# Autodesk Inventor assembly: 1.4_EndEffector
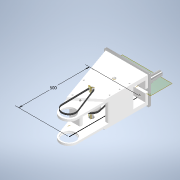
[picture p0: Inventor's stored thumbnail of the model, 180x180]
Saved by Autodesk Inventor 2021 (Build 250183000, 183)
## iProperties
Created: 2025-11-13
Part Number: 1.4_EndEffector
Document SubType Name: Assembly
Designer: Admin
Mass: 13627.3 g
Surface Area: 10535.7 cm^2
Volume: 8904.12 cm^3
Density: 1.53045 g/cm^3
Author: Admin
## Documents named in this file (32)
- C:\Users\Admin\OneDrive - Politecnico di Milano\File di Erwin Rafael Novicio - Industrial Robotics SY 25-26\3D Model\COBOT - no shaftkeys\1.1_FixedArm.iam
- C:\Users\Admin\OneDrive - Politecnico di Milano\File di Erwin Rafael Novicio - Industrial Robotics SY 25-26\3D Model\COBOT - no shaftkeys\1.1_1_SideArm.ipt
- C:\Users\Admin\OneDrive - Politecnico di Milano\File di Erwin Rafael Novicio - Industrial Robotics SY 25-26\3D Model\COBOT - no shaftkeys\HG-MR23B-K.ipt
- C:\Users\Admin\OneDrive - Politecnico di Milano\File di Erwin Rafael Novicio - Industrial Robotics SY 25-26\3D Model\COBOT - no shaftkeys\1.1_3_Shaft_A.ipt
- C:\Users\Admin\OneDrive - Politecnico di Milano\File di Erwin Rafael Novicio - Industrial Robotics SY 25-26\3D Model\COBOT - no shaftkeys\1.1_4_Shaft_B.ipt
- C:\Users\Admin\OneDrive - Politecnico di Milano\File di Erwin Rafael Novicio - Industrial Robotics SY 25-26\3D Model\COBOT - no shaftkeys\1.1_2_SideArmClose.ipt
- C:\Users\Admin\OneDrive - Politecnico di Milano\File di Erwin Rafael Novicio - Industrial Robotics SY 25-26\3D Model\COBOT - no shaftkeys\BEARING_61903-2RZ.ipt
- C:\Users\Admin\OneDrive - Politecnico di Milano\File di Erwin Rafael Novicio - Industrial Robotics SY 25-26\3D Model\COBOT - no shaftkeys\1.1_5_Base.ipt
- C:\Users\Admin\OneDrive - Politecnico di Milano\File di Erwin Rafael Novicio - Industrial Robotics SY 25-26\3D Model\COBOT - no shaftkeys\Timing_Pulley_22002-051015.ipt
- C:\Users\Admin\OneDrive - Politecnico di Milano\File di Erwin Rafael Novicio - Industrial Robotics SY 25-26\3D Model\COBOT - no shaftkeys\BEARING_628-2Z.ipt
- C:\Users\Admin\Documents\Inventor\Content Center Files\R2021\en-US\ISO 4762(2)\ISO 4762 - M5 x 25ISO.ipt
- C:\Users\Admin\Documents\Inventor\Content Center Files\R2021\en-US\ISO 7042(2)\ISO 7042 - M5 - ISO.ipt
- C:\Users\Admin\OneDrive - Politecnico di Milano\File di Erwin Rafael Novicio - Industrial Robotics SY 25-26\3D Model\COBOT - no shaftkeys\M6 Unheaded Heat-Sert Insert for Plastic.ipt
- C:\Users\Admin\OneDrive - Politecnico di Milano\File di Erwin Rafael Novicio - Industrial Robotics SY 25-26\3D Model\COBOT - no shaftkeys\Timing_Pulley_22002-051060_V3.ipt
- C:\Users\Admin\Documents\Inventor\Content Center Files\R2021\en-US\DIN 471(1)\DIN 471 - 10x1.ipt
- C:\Users\Admin\OneDrive - Politecnico di Milano\File di Erwin Rafael Novicio - Industrial Robotics SY 25-26\3D Model\COBOT - no shaftkeys\1.1_6_SpacerA.ipt
- C:\Users\Admin\OneDrive - Politecnico di Milano\File di Erwin Rafael Novicio - Industrial Robotics SY 25-26\3D Model\COBOT - no shaftkeys\Timing_Pulley_22002-051060_V1.ipt
- C:\Users\Admin\Documents\Inventor\Content Center Files\R2021\en-US\DIN 471(1)\DIN 471 - 14x1.ipt
- C:\Users\Admin\OneDrive - Politecnico di Milano\File di Erwin Rafael Novicio - Industrial Robotics SY 25-26\3D Model\COBOT - no shaftkeys\1.1_7_SpacerB.ipt
- C:\Users\Admin\Documents\Inventor\Content Center Files\R2021\en-US\ISO 7042(2)\ISO 7042 - M8 - ISO.ipt
- C:\Users\Admin\Documents\Inventor\Content Center Files\R2021\en-US\ISO 4762(2)\ISO 4762 - M8 x 30ISO.ipt
- C:\Users\Admin\OneDrive - Politecnico di Milano\File di Erwin Rafael Novicio - Industrial Robotics SY 25-26\3D Model\COBOT - no shaftkeys\Timing_Pulley_22002-051020_V1.ipt
- C:\Users\Admin\Documents\Inventor\Content Center Files\R2021\en-US\DIN 835\DIN 835 - M4 x 25 - 0.7.ipt
- C:\Users\Admin\Documents\Inventor\Content Center Files\R2021\en-US\DIN 439-2\DIN 439 - M4 x 0.7.ipt
- C:\Users\Admin\Documents\Inventor\Content Center Files\R2021\en-US\DIN 555\DIN 555-5 - M4.ipt
- C:\Users\Admin\OneDrive - Politecnico di Milano\File di Erwin Rafael Novicio - Industrial Robotics SY 25-26\3D Model\COBOT - no shaftkeys\1.2_4_SpacerA.ipt
- C:\Users\Admin\OneDrive - Politecnico di Milano\File di Erwin Rafael Novicio - Industrial Robotics SY 25-26\3D Model\COBOT - no shaftkeys\1.2_5_SpacerB.ipt
- C:\Users\Admin\Documents\Inventor\Content Center Files\R2021\en-US\ISO 4762(2)\ISO 4762 - M6 x 25ISO.ipt
- C:\Users\Admin\Documents\Inventor\Content Center Files\R2021\en-US\ISO 4762(2)\ISO 4762 - M8 x 35ISO.ipt
- C:\Users\Admin\OneDrive - Politecnico di Milano\File di Erwin Rafael Novicio - Industrial Robotics SY 25-26\3D Model\COBOT - no shaftkeys\TiminigBelt_D.ipt
- C:\Users\Admin\OneDrive - Politecnico di Milano\File di Erwin Rafael Novicio - Industrial Robotics SY 25-26\3D Model\COBOT - no shaftkeys\TiminigBelt_E.ipt
- C:\Users\Admin\OneDrive - Politecnico di Milano\File di Erwin Rafael Novicio - Industrial Robotics SY 25-26\3D Model\COBOT - no shaftkeys\TiminigBelt_F.ipt
## Components (57 placed, 31 different names)
1. 1.1_1_SideArm:1 — Mate:1, Flush:1, Mate:2, Mate:4, Mate:16, Mate:17, Mate:18, Mate:19, Mate:20, Flush:4, Mate:21, Mate:29, Mate:30, Flush:7, Mate:31, Mate:39, Mate:52, Mate:54, Mate:63, Mate:64, Flush:10, Flush:11, Mate:65, Mate:66, Mate:67, Mate:68, Mate:69, Flush:12, Flush:13, Flush:14, Flush:15, Flush:16, Flush:17, Mate:109, Mate:111, Mate:112
2. HG-KR23B:1 — Mate:4, Mate:18, Mate:19, Mate:36, Mate:37, Mate:126, Mate:130, Mate:131, Mate:132
3. 1.1_3_Shaft_A:1 — Mate:29, Mate:30, Mate:88, Mate:89, Mate:90, Mate:98, Mate:100, Mate:101, Mate:102, Mate:151
4. 1.1_5_Shaft_C:1 — Mate:21, Mate:22, Mate:70, Mate:71, Mate:72, Mate:77, Mate:81, Mate:82, Mate:84, Mate:149
5. 1.1_2_SideArmClose:1 — Mate:16, Mate:17, Mate:24, Flush:5, Flush:9, Mate:35, Mate:50, Mate:107, Mate:108, Mate:110, Mate:135, Mate:136, Mate:137, Mate:138, Mate:139, Mate:140, Mate:141, Mate:142, Mate:143, Mate:148
6. BEARING_61903-2RZ:1 — Mate:20, Flush:4, Mate:22
7. BEARING_61903-2RZ:2 — Mate:24, Flush:5
8. 1.1_5_Base:1 — Mate:50, Mate:52, Mate:53, Mate:54, Mate:104, Mate:105, Mate:114, Mate:144, Angle:1, Angle:2, Angle:3, Angle:4
9. BEARING_61903-2RZ:3 — Flush:7, Mate:31
10. BEARING_628-2Z:1 — Flush:9, Mate:35
11. M6 Unheaded Heat-Sert Insert for Plastic:1 — Mate:64, Flush:10
12. M6 Unheaded Heat-Sert Insert for Plastic:2 — Mate:66, Flush:14
13. M6 Unheaded Heat-Sert Insert for Plastic:3 — Mate:69, Flush:12, Flush:17
14. M6 Unheaded Heat-Sert Insert for Plastic:4 — Mate:65, Flush:13
15. M6 Unheaded Heat-Sert Insert for Plastic:5 — Mate:63, Flush:11
16. M6 Unheaded Heat-Sert Insert for Plastic:6 — Mate:68, Flush:16
17. M6 Unheaded Heat-Sert Insert for Plastic:7 — Mate:67, Flush:15
18. Timing_Pulley_22002-051060_V3:1 — Mate:70, Mate:77, Mate:85
19. Timing_Pulley_22002-051015:2 — Mate:71, Mate:72, Flush:26
20. DIN 471 10x1:1 — Mate:81, Mate:82
21. 1.1_6_SpacerA:1 — Mate:84, Mate:85
22. Timing_Pulley_22002-051015:3 — Mate:100, Mate:101, Mate:103, Flush:27
23. Timing_Pulley_22002-051060_V1:1 — Mate:88, Mate:98
24. DIN 471 14x1:2 — Mate:89, Mate:90
25. 1.1_7_SpacerB:2 — Mate:102, Mate:103, Mate:150
26. ISO 7042 M8:1 — Mate:104, Mate:105, Angle:4
27. ISO 4762 M8 x 30:1 — Mate:111, Mate:112
28. ISO 4762 M8 x 30:2 — Flush:18, Mate:110, Mate:116
29. ISO 4762 M8 x 35:1 — Flush:19, Mate:107, Mate:108, Mate:115
30. ISO 4762 M8 x 35:2 — Flush:18, Flush:19, Mate:109, Mate:113
31. ISO 7042 M8:2 — Flush:20, Mate:114, Mate:116, Angle:3
32. ISO 7042 M8:3 — Mate:113, Mate:144, Angle:2
33. ISO 7042 M8:4 — Flush:20, Mate:115, Angle:1
34. Timing_Pulley_22002-051020_V1:1 — Mate:134, Mate:152
35. DIN 835 M4 x 25:1 — Mate:131, Mate:132
36. DIN 439-2 - replaced by DIN EN 24035/28675 M4:1
37. DIN 555 - replaced by DIN EN 24034 M4:1
38. 1.2_4_SpacerA:1
39. 1.2_5_SpacerB:1 — Mate:126, Mate:130, Mate:134
40. ISO 4762 M6 x 25:1 — Flush:21, Flush:22, Mate:135, Mate:136
41. ISO 4762 M6 x 25:2 — Flush:23, Flush:24, Flush:25, Mate:141
42. ISO 4762 M6 x 25:3 — Flush:21, Mate:138
43. ISO 4762 M6 x 25:4 — Flush:22, Mate:137
44. ISO 4762 M6 x 25:5 — Flush:23, Mate:139, Mate:140
45. ISO 4762 M6 x 25:6 — Flush:24, Mate:142
46. ISO 4762 M6 x 25:7 — Flush:25, Mate:143
47. TiminigBelt_D:1 — Mate:148, Flush:26
48. TiminigBelt_E:1 — Mate:149, Mate:150, Flush:27
49. TiminigBelt_F:1 — Mate:151, Mate:152
50. ISO 7042 M5:1 — Mate:38, Mate:39
51. ISO 4762 M5 x 25:1 — Mate:36, Mate:37, Mate:38
52. ISO 7042 M5:2
53. ISO 4762 M5 x 25:2
54. ISO 7042 M5:3
55. ISO 4762 M5 x 25:3
56. ISO 7042 M5:4
57. ISO 4762 M5 x 25:4
## Component patterns: (4 elements, first: ISO 7042 M5:1 + ISO 4762 M5 x 25:1)
## Relationships (112: Mate 85, Flush 23, Angle 4)
- Mate:1 (-67 mm): 1.1_1_SideArm:1
- Flush:1: 1.1_1_SideArm:1
- Mate:2: 1.1_1_SideArm:1
- Mate:4: 1.1_1_SideArm:1 ↔ HG-KR23B:1
- Mate:16: 1.1_1_SideArm:1 ↔ 1.1_2_SideArmClose:1
- Mate:17: 1.1_1_SideArm:1 ↔ 1.1_2_SideArmClose:1
- Mate:18: 1.1_1_SideArm:1 ↔ HG-KR23B:1
- Mate:19: 1.1_1_SideArm:1 ↔ HG-KR23B:1
- Mate:20: 1.1_1_SideArm:1 ↔ BEARING_61903-2RZ:1
- Flush:4: 1.1_1_SideArm:1 ↔ BEARING_61903-2RZ:1
- Mate:21: 1.1_1_SideArm:1 ↔ 1.1_5_Shaft_C:1
- Mate:22: 1.1_5_Shaft_C:1 ↔ BEARING_61903-2RZ:1
- Mate:24: 1.1_2_SideArmClose:1 ↔ BEARING_61903-2RZ:2
- Flush:5: 1.1_2_SideArmClose:1 ↔ BEARING_61903-2RZ:2
- Mate:29: 1.1_1_SideArm:1 ↔ 1.1_3_Shaft_A:1
- Mate:30: 1.1_1_SideArm:1 ↔ 1.1_3_Shaft_A:1
- Flush:7: 1.1_1_SideArm:1 ↔ BEARING_61903-2RZ:3
- Mate:31: 1.1_1_SideArm:1 ↔ BEARING_61903-2RZ:3
- Flush:9: 1.1_2_SideArmClose:1 ↔ BEARING_628-2Z:1
- Mate:35: 1.1_2_SideArmClose:1 ↔ BEARING_628-2Z:1
- Mate:36: HG-KR23B:1 ↔ ISO 4762 M5 x 25:1
- Mate:37: HG-KR23B:1 ↔ ISO 4762 M5 x 25:1
- Mate:38: ISO 7042 M5:1 ↔ ISO 4762 M5 x 25:1
- Mate:39: 1.1_1_SideArm:1 ↔ ISO 7042 M5:1
- Mate:50: 1.1_2_SideArmClose:1 ↔ 1.1_5_Base:1
- Mate:52: 1.1_1_SideArm:1 ↔ 1.1_5_Base:1
- Mate:53: 1.1_5_Base:1
- Mate:54: 1.1_1_SideArm:1 ↔ 1.1_5_Base:1
- Mate:63: 1.1_1_SideArm:1 ↔ M6 Unheaded Heat-Sert Insert for Plastic:5
- Mate:64: 1.1_1_SideArm:1 ↔ M6 Unheaded Heat-Sert Insert for Plastic:1
- Flush:10: 1.1_1_SideArm:1 ↔ M6 Unheaded Heat-Sert Insert for Plastic:1
- Flush:11: 1.1_1_SideArm:1 ↔ M6 Unheaded Heat-Sert Insert for Plastic:5
- Mate:65: 1.1_1_SideArm:1 ↔ M6 Unheaded Heat-Sert Insert for Plastic:4
- Mate:66: 1.1_1_SideArm:1 ↔ M6 Unheaded Heat-Sert Insert for Plastic:2
- Mate:67: 1.1_1_SideArm:1 ↔ M6 Unheaded Heat-Sert Insert for Plastic:7
- Mate:68: 1.1_1_SideArm:1 ↔ M6 Unheaded Heat-Sert Insert for Plastic:6
- Mate:69: 1.1_1_SideArm:1 ↔ M6 Unheaded Heat-Sert Insert for Plastic:3
- Flush:12: 1.1_1_SideArm:1 ↔ M6 Unheaded Heat-Sert Insert for Plastic:3
- Flush:13: 1.1_1_SideArm:1 ↔ M6 Unheaded Heat-Sert Insert for Plastic:4
- Flush:14: 1.1_1_SideArm:1 ↔ M6 Unheaded Heat-Sert Insert for Plastic:2
- Flush:15: 1.1_1_SideArm:1 ↔ M6 Unheaded Heat-Sert Insert for Plastic:7
- Flush:16: 1.1_1_SideArm:1 ↔ M6 Unheaded Heat-Sert Insert for Plastic:6
- Flush:17: 1.1_1_SideArm:1 ↔ M6 Unheaded Heat-Sert Insert for Plastic:3
- Mate:70: 1.1_5_Shaft_C:1 ↔ Timing_Pulley_22002-051060_V3:1
- Mate:71: 1.1_5_Shaft_C:1 ↔ Timing_Pulley_22002-051015:2
- Mate:72: 1.1_5_Shaft_C:1 ↔ Timing_Pulley_22002-051015:2
- Mate:77: 1.1_5_Shaft_C:1 ↔ Timing_Pulley_22002-051060_V3:1
- Mate:81: 1.1_5_Shaft_C:1 ↔ DIN 471 10x1:1
- Mate:82: 1.1_5_Shaft_C:1 ↔ DIN 471 10x1:1
- Mate:84: 1.1_5_Shaft_C:1 ↔ 1.1_6_SpacerA:1
- Mate:85: Timing_Pulley_22002-051060_V3:1 ↔ 1.1_6_SpacerA:1
- Mate:88: 1.1_3_Shaft_A:1 ↔ Timing_Pulley_22002-051060_V1:1
- Mate:89: 1.1_3_Shaft_A:1 ↔ DIN 471 14x1:2
- Mate:90: 1.1_3_Shaft_A:1 ↔ DIN 471 14x1:2
- Mate:98: 1.1_3_Shaft_A:1 ↔ Timing_Pulley_22002-051060_V1:1
- Mate:100: 1.1_3_Shaft_A:1 ↔ Timing_Pulley_22002-051015:3
- Mate:101: 1.1_3_Shaft_A:1 ↔ Timing_Pulley_22002-051015:3
- Mate:102: 1.1_3_Shaft_A:1 ↔ 1.1_7_SpacerB:2
- Mate:103: Timing_Pulley_22002-051015:3 ↔ 1.1_7_SpacerB:2
- Mate:104: 1.1_5_Base:1 ↔ ISO 7042 M8:1
- Mate:105: 1.1_5_Base:1 ↔ ISO 7042 M8:1
- Flush:18: ISO 4762 M8 x 30:2 ↔ ISO 4762 M8 x 35:2
- Flush:19: ISO 4762 M8 x 35:1 ↔ ISO 4762 M8 x 35:2
- Mate:107: 1.1_2_SideArmClose:1 ↔ ISO 4762 M8 x 35:1
- Mate:108: 1.1_2_SideArmClose:1 ↔ ISO 4762 M8 x 35:1
- Mate:109: 1.1_1_SideArm:1 ↔ ISO 4762 M8 x 35:2
- Mate:110: 1.1_2_SideArmClose:1 ↔ ISO 4762 M8 x 30:2
- Mate:111: 1.1_1_SideArm:1 ↔ ISO 4762 M8 x 30:1
- Mate:112: 1.1_1_SideArm:1 ↔ ISO 4762 M8 x 30:1
- Mate:113: ISO 4762 M8 x 35:2 ↔ ISO 7042 M8:3
- Flush:20: ISO 7042 M8:2 ↔ ISO 7042 M8:4
- Mate:114: 1.1_5_Base:1 ↔ ISO 7042 M8:2
- Mate:115: ISO 4762 M8 x 35:1 ↔ ISO 7042 M8:4
- Mate:116: ISO 4762 M8 x 30:2 ↔ ISO 7042 M8:2
- [Mate]: Timing_Pulley_22002-051020_V1:1 ↔ DIN 835 M4 x 25:1
- [Mate]: DIN 439-2 - replaced by DIN EN 24035/28675 M4:1 ↔ DIN 555 - replaced by DIN EN 24034 M4:1
- [Mate]: DIN 439-2 - replaced by DIN EN 24035/28675 M4:1 ↔ DIN 555 - replaced by DIN EN 24034 M4:1
- [Mate]: DIN 835 M4 x 25:1 ↔ DIN 439-2 - replaced by DIN EN 24035/28675 M4:1
- [Mate]: DIN 835 M4 x 25:1 ↔ 1.2_4_SpacerA:1
- [Mate]: Timing_Pulley_22002-051020_V1:1 ↔ 1.2_4_SpacerA:1
- [Mate]: DIN 555 - replaced by DIN EN 24034 M4:1 ↔ 1.2_4_SpacerA:1
- Mate:126: HG-KR23B:1 ↔ 1.2_5_SpacerB:1
- Mate:130: HG-KR23B:1 ↔ 1.2_5_SpacerB:1
- Mate:131 (-13 mm): HG-KR23B:1 ↔ DIN 835 M4 x 25:1
- Mate:132: HG-KR23B:1 ↔ DIN 835 M4 x 25:1
- Mate:134: Timing_Pulley_22002-051020_V1:1 ↔ 1.2_5_SpacerB:1
- Flush:21: ISO 4762 M6 x 25:1 ↔ ISO 4762 M6 x 25:3
- Flush:22: ISO 4762 M6 x 25:1 ↔ ISO 4762 M6 x 25:4
- Flush:23: ISO 4762 M6 x 25:2 ↔ ISO 4762 M6 x 25:5
- Flush:24: ISO 4762 M6 x 25:2 ↔ ISO 4762 M6 x 25:6
- Flush:25: ISO 4762 M6 x 25:2 ↔ ISO 4762 M6 x 25:7
- Mate:135: 1.1_2_SideArmClose:1 ↔ ISO 4762 M6 x 25:1
- Mate:136: 1.1_2_SideArmClose:1 ↔ ISO 4762 M6 x 25:1
- Mate:137: 1.1_2_SideArmClose:1 ↔ ISO 4762 M6 x 25:4
- Mate:138: 1.1_2_SideArmClose:1 ↔ ISO 4762 M6 x 25:3
- Mate:139: 1.1_2_SideArmClose:1 ↔ ISO 4762 M6 x 25:5
- Mate:140: 1.1_2_SideArmClose:1 ↔ ISO 4762 M6 x 25:5
- Mate:141: 1.1_2_SideArmClose:1 ↔ ISO 4762 M6 x 25:2
- Mate:142: 1.1_2_SideArmClose:1 ↔ ISO 4762 M6 x 25:6
- Mate:143: 1.1_2_SideArmClose:1 ↔ ISO 4762 M6 x 25:7
- Mate:144: 1.1_5_Base:1 ↔ ISO 7042 M8:3
- Angle:1 (0 deg): 1.1_5_Base:1 ↔ ISO 7042 M8:4
- Angle:2 (0 deg): 1.1_5_Base:1 ↔ ISO 7042 M8:3
- Angle:3 (0 deg): 1.1_5_Base:1 ↔ ISO 7042 M8:2
- Angle:4 (0 deg): 1.1_5_Base:1 ↔ ISO 7042 M8:1
- Mate:148: 1.1_2_SideArmClose:1 ↔ TiminigBelt_D:1
- Flush:26 (2.5 mm): Timing_Pulley_22002-051015:2 ↔ TiminigBelt_D:1
- Mate:149: 1.1_5_Shaft_C:1 ↔ TiminigBelt_E:1
- Mate:150: 1.1_7_SpacerB:2 ↔ TiminigBelt_E:1
- Flush:27 (-2.5 mm): Timing_Pulley_22002-051015:3 ↔ TiminigBelt_E:1
- Mate:151: 1.1_3_Shaft_A:1 ↔ TiminigBelt_F:1
- Mate:152 (2.5 mm): Timing_Pulley_22002-051020_V1:1 ↔ TiminigBelt_F:1
## Named parameters: d157_d100 = 0 mm, d159_d102 = 0 mm, d162_d65 = 0 mm, d164_d68 = 0 mm
